# Autodesk Inventor assembly: Assembly1
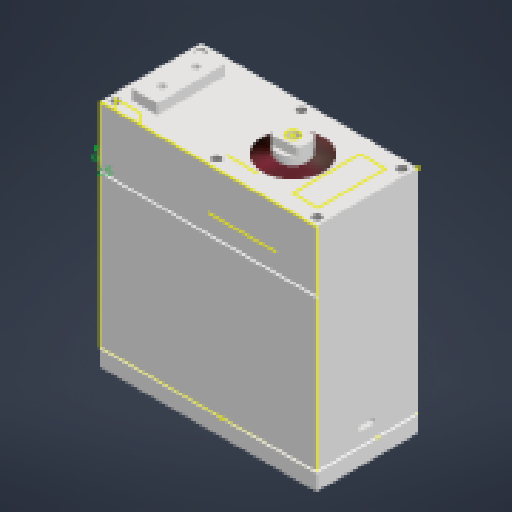
[picture p0: Inventor's stored thumbnail of the model, 512x512]
Saved by Autodesk Inventor 2027 (Build 310192060, 192F)
## iProperties
Created: 2026-08-12
Part Number: Assembly1
Document SubType Name: Assembly
Designer: Laptop
Author: Laptop
## Documents named in this file (8)
- C:\Users\thita\Downloads\v3 hop\Workgroups\NotInProject\Assembly1.iam
- C:\Users\thita\Downloads\v3 hop\Workgroups\NotInProject\cátrục (1).ipt
- C:\Users\thita\Downloads\v3 hop\Workgroups\NotInProject\cáhộp servo (2) (1).ipt
- C:\Users\thita\Downloads\v3 hop\Workgroups\NotInProject\cánap duoi servo (1) (2).ipt
- C:\Users\thita\Downloads\v3 hop\Workgroups\NotInProject\cánap tren servo_MIR_MIR.ipt
- C:\Users\thita\Downloads\v3 hop\Workgroups\NotInProject\bạc đạn 8x16x5 2rs.ipt
- C:\Users\thita\Downloads\v3 hop\Workgroups\NotInProject\phớt chặn dầu 8x18x5.ipt
- C:\Users\thita\Downloads\v3 hop\Workgroups\NotInProject\Servo-9imod-DS35MG-180.ipt
## Components (7 placed, 7 different names)
1. cátrục (1):1 — Mate:9, Mate:10, Mate:14
2. cáhộp servo (2) (1):1 — Mate:1, Mate:2, Mate:11, Mate:12
3. cánap duoi servo (1) (2):1 — Mate:1, Mate:2, Mate:15
4. cánap tren servo_MIR_MIR:1 — Mate:11, Mate:12, Mate:13
5. bạc đạn 8x16x5 2rs:1 — Mate:9, Mate:10
6. phớt chặn dầu 8x18x5:1 — Mate:13, Mate:14
7. Servo-9imod-DS35MG-180:1 — Mate:15
## Relationships (9: Mate 9)
- Mate:1: cáhộp servo (2) (1):1 ↔ cánap duoi servo (1) (2):1
- Mate:2 (0.01 mm): cáhộp servo (2) (1):1 ↔ cánap duoi servo (1) (2):1
- Mate:9: cátrục (1):1 ↔ bạc đạn 8x16x5 2rs:1
- Mate:10: cátrục (1):1 ↔ bạc đạn 8x16x5 2rs:1
- Mate:11: cáhộp servo (2) (1):1 ↔ cánap tren servo_MIR_MIR:1
- Mate:12: cáhộp servo (2) (1):1 ↔ cánap tren servo_MIR_MIR:1
- Mate:13: cánap tren servo_MIR_MIR:1 ↔ phớt chặn dầu 8x18x5:1
- Mate:14: cátrục (1):1 ↔ phớt chặn dầu 8x18x5:1
- Mate:15: cánap duoi servo (1) (2):1 ↔ Servo-9imod-DS35MG-180:1
